# Autodesk Inventor assembly: water_release_V8_assembly
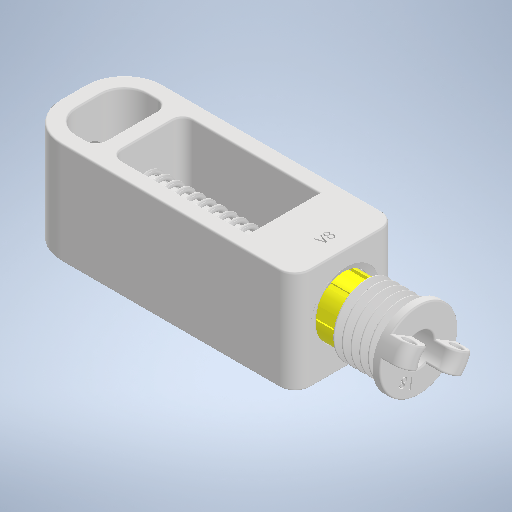
[picture p0: Inventor's stored thumbnail of the model, 512x512]
Saved by Autodesk Inventor 2025.2 (Build 292293000, 293)
## iProperties
Created: 2026-04-10
Part Number: water_release_V8_assembly
Document SubType Name: Assembly
Designer: Eden Salzig
Author: Eden Salzig
## Documents named in this file (6)
- C:\Users\eden.salzig\OneDrive - Woods Hole Oceanographic Institution\Documents\Inventor\Parts and Assemblies\Water Release\water_release_v8\water_release_V8_assembly.iam
- C:\Users\eden.salzig\OneDrive - Woods Hole Oceanographic Institution\Documents\Inventor\Parts and Assemblies\Water Release\water_release_v8\water_release_V8_frame.ipt
- C:\Users\eden.salzig\OneDrive - Woods Hole Oceanographic Institution\Documents\Inventor\Parts and Assemblies\Water Release\water_release_v8\water_release_V8_pin.ipt
- C:\Users\eden.salzig\OneDrive - Woods Hole Oceanographic Institution\Documents\Inventor\Parts and Assemblies\Water Release\water_release_v8\water_release_V8_screw.ipt
- C:\Users\eden.salzig\OneDrive - Woods Hole Oceanographic Institution\Documents\Inventor\Parts and Assemblies\Water Release\9657K352_Compression Spring.ipt
- C:\Users\eden.salzig\OneDrive - Woods Hole Oceanographic Institution\Documents\Inventor\Parts and Assemblies\Water Release\starch_collar.ipt
## Components (5 placed, 5 different names)
1. water_release_V8_frame:1 — Mate:2, Mate:3, Mate:4, Mate:5
2. water_release_V8_pin:1 — Mate:3, Mate:7
3. water_release_V8_screw:1 — Mate:2, Mate:6
4. 9657K352_Compression Spring:1 — Mate:4, Mate:7
5. starch_collar:1 — Mate:5, Mate:6
## Relationships (6: Mate 6)
- Mate:2: water_release_V8_frame:1 ↔ water_release_V8_screw:1
- Mate:3: water_release_V8_frame:1 ↔ water_release_V8_pin:1
- Mate:4: water_release_V8_frame:1 ↔ 9657K352_Compression Spring:1
- Mate:5: water_release_V8_frame:1 ↔ starch_collar:1
- Mate:6: water_release_V8_screw:1 ↔ starch_collar:1
- Mate:7: water_release_V8_pin:1 ↔ 9657K352_Compression Spring:1
